(part 1 of 3)
# Autodesk Inventor assembly: ASSEMBLY_DUT_Ant_Rotator_REVC
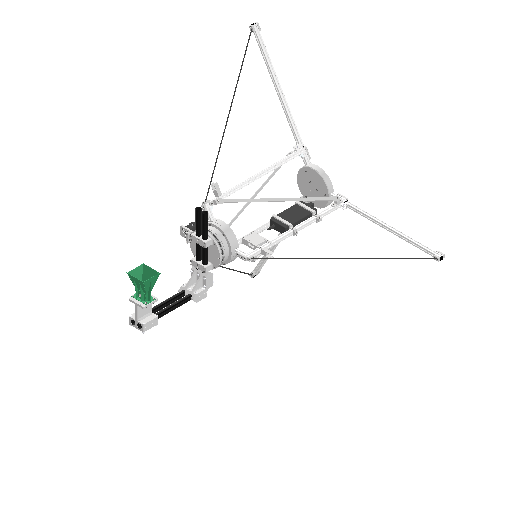
[picture p0: Inventor's stored thumbnail of the model, 512x512]
Saved by Autodesk Inventor 2027 (Build 310192060, 192F)
## iProperties
Created: 2026-01-06
Part Number: ASSEMBLY_DUT_Ant_Rotator_REVC
Document SubType Name: Assembly
Designer: User
Author: User
## Documents named in this file (74)
- C:\Users\lacze\OneDrive\_DRIVE_SYNCH_FILES\RF - Antenna Positioner\MCAD\1_V1\ASSEMBLY_DUT_ANT_ROTATOR_REVC\ASSEMBLY_DUT_Ant_Rotator_REVC.iam
- C:\Users\lacze\OneDrive\_DRIVE_SYNCH_FILES\RF - Antenna Positioner\MCAD\1_V1\__COTS_PARTS\COTS_CARBONCENTER_Fiberglass_Tube_27x24x383mm.ipt
- C:\Users\lacze\OneDrive\_DRIVE_SYNCH_FILES\RF - Antenna Positioner\MCAD\1_V1\__COTS_PARTS\COTS_GENERIC_6020_2RS_150x100x24mm_Ball_Bearing\COTS_GENERIC_6020_2RS_150x100x24mm_Ball_Bearing.ipt
- C:\Users\lacze\OneDrive\_DRIVE_SYNCH_FILES\RF - Antenna Positioner\MCAD\1_V1\ASSEMBLY_DUT_ANT_ROTATOR_REVA\3DP_PLA_A_Axis_Bearing_Base.ipt
- C:\Users\lacze\OneDrive\_DRIVE_SYNCH_FILES\RF - Antenna Positioner\MCAD\1_V1\ASSEMBLY_DUT_ANT_ROTATOR_REVA\3DP_PLA_A_Axis_Bearing_Base_Bearing_Locking_Ring.ipt
- C:\Users\lacze\OneDrive\_DRIVE_SYNCH_FILES\RF - Antenna Positioner\MCAD\1_V1\__CONTENT_CENTER_PARTS\en-US\ISO 7380-1\ISO 7380-1 - M4 x 40.ipt
- C:\Users\lacze\OneDrive\_DRIVE_SYNCH_FILES\RF - Antenna Positioner\MCAD\1_V1\__CONTENT_CENTER_PARTS\en-US\DIN 934\DIN 934 - M4 x 0,7.ipt
- C:\Users\lacze\OneDrive\_DRIVE_SYNCH_FILES\RF - Antenna Positioner\MCAD\1_V1\ASSEMBLY_DUT_ANT_ROTATOR_REVA\3DP_PLA_A_Axis_Rotating_Stage.ipt
- C:\Users\lacze\OneDrive\_DRIVE_SYNCH_FILES\RF - Antenna Positioner\MCAD\1_V1\ASSEMBLY_DUT_ANT_ROTATOR_REVA\3DP_PLA_A_Axis_Rotating_Stage_Mounting_Plate.ipt
- C:\Users\lacze\OneDrive\_DRIVE_SYNCH_FILES\RF - Antenna Positioner\MCAD\1_V1\__CONTENT_CENTER_PARTS\en-US\DIN 912\DIN 912 - M5 x 0,8 x 50 x 22.ipt
- C:\Users\lacze\OneDrive\_DRIVE_SYNCH_FILES\RF - Antenna Positioner\MCAD\1_V1\__CONTENT_CENTER_PARTS\en-US\DIN 934\DIN 934 - M5 x 0,8.ipt
- C:\Users\lacze\OneDrive\_DRIVE_SYNCH_FILES\RF - Antenna Positioner\MCAD\1_V1\__COTS_PARTS\COTS_GENERIC_HTD3M_24T_6mm_5mm_shaft_pulley.ipt
- C:\Users\lacze\OneDrive\_DRIVE_SYNCH_FILES\RF - Antenna Positioner\MCAD\1_V1\__COTS_PARTS\COTS_GENERIC_HTD3M_6mm_675mm_Closed_belt_A_Axis.ipt
- C:\Users\lacze\OneDrive\_DRIVE_SYNCH_FILES\RF - Antenna Positioner\MCAD\1_V1\ASSEMBLY_DUT_ANT_ROTATOR_REVA\ASSEMBLY_HTD3M_Idler_A_Axis.iam
- C:\Users\lacze\OneDrive\_DRIVE_SYNCH_FILES\RF - Antenna Positioner\MCAD\1_V1\__CONTENT_CENTER_PARTS\en-US\DIN 125-1  A\DIN 125 - A 3,2.ipt
- C:\Users\lacze\OneDrive\_DRIVE_SYNCH_FILES\RF - Antenna Positioner\MCAD\1_V1\__CONTENT_CENTER_PARTS\en-US\ISO 7380-1\ISO 7380-1 - M3 x 16.ipt
- C:\Users\lacze\OneDrive\_DRIVE_SYNCH_FILES\RF - Antenna Positioner\MCAD\1_V1\ASSEMBLY_DUT_ANT_ROTATOR_REVA\3DP_PLA_A_Axis_Rotating_Stage_Fiberglass_pipes_mount_plate.ipt
- C:\Users\lacze\OneDrive\_DRIVE_SYNCH_FILES\RF - Antenna Positioner\MCAD\1_V1\ASSEMBLY_DUT_ANT_ROTATOR_REVA\3DP_PLA_A_Axis_Rotating_Stage_Fiberglass_pipes_mount_clamp.ipt
- C:\Users\lacze\OneDrive\_DRIVE_SYNCH_FILES\RF - Antenna Positioner\MCAD\1_V1\__CONTENT_CENTER_PARTS\en-US\DIN 912\DIN 912 - M4 x 0,7 x 20 x 18,25.ipt
- C:\Users\lacze\OneDrive\_DRIVE_SYNCH_FILES\RF - Antenna Positioner\MCAD\1_V1\__COTS_PARTS\COTS_MKS_SERVO42D_40mm.ipt
- C:\Users\lacze\OneDrive\_DRIVE_SYNCH_FILES\RF - Antenna Positioner\MCAD\1_V1\ASSEMBLY_DUT_ANT_ROTATOR_REVA\3DP_PLA_Fiberglass_Pipe_Corner_Bracket.ipt
- C:\Users\lacze\OneDrive\_DRIVE_SYNCH_FILES\RF - Antenna Positioner\MCAD\1_V1\ASSEMBLY_DUT_ANT_ROTATOR_REVA\3DP_PLA_Fiberglass_Pipe_Corner_Bracket_Clamp.ipt
- C:\Users\lacze\OneDrive\_DRIVE_SYNCH_FILES\RF - Antenna Positioner\MCAD\1_V1\__COTS_PARTS\COTS_DREMEC_8G206M6X50_M6x50_Nylon_Screw.ipt
- COTS_DREMEC_8G206M6X50_M6x50_Nylon_Screw.ipt
- C:\Users\lacze\OneDrive\_DRIVE_SYNCH_FILES\RF - Antenna Positioner\MCAD\1_V1\__COTS_PARTS\COTS_BOSSARD_1400444_M6_Nylon_Nut.ipt
- C:\Users\lacze\OneDrive\_DRIVE_SYNCH_FILES\RF - Antenna Positioner\MCAD\1_V1\__CONTENT_CENTER_PARTS\en-US\DIN 912\DIN 912 - M4 x 0,7 x 35 x 20.ipt
- C:\Users\lacze\OneDrive\_DRIVE_SYNCH_FILES\RF - Antenna Positioner\MCAD\1_V1\__COTS_PARTS\COTS_BYTECHLAB_COAXIAL_FEED_HORN\COTS_BYTECHLAB_Coaxial_Feed_Horn.iam
- C:\Users\lacze\OneDrive\_DRIVE_SYNCH_FILES\RF - Antenna Positioner\MCAD\1_V1\ASSEMBLY_DUT_ANT_ROTATOR_REVA\3DP_PLA_Antenna_Boom_Fiberglass_Pipe_Clamp.ipt
- C:\Users\lacze\OneDrive\_DRIVE_SYNCH_FILES\RF - Antenna Positioner\MCAD\1_V1\__COTS_PARTS\COTS_Profihot_HC-2-22x16_Zip_Tie_Anchor.ipt
- C:\Users\lacze\OneDrive\_DRIVE_SYNCH_FILES\RF - Antenna Positioner\MCAD\1_V1\__COTS_PARTS\COTS_BOSSARD_1386883_M4_Threaded_Insert\COTS_BOSSARD_1386883_M4_Threaded_Insert.ipt
- C:\Users\lacze\OneDrive\_DRIVE_SYNCH_FILES\RF - Antenna Positioner\MCAD\1_V1\__CONTENT_CENTER_PARTS\en-US\DIN 125-1  A\DIN 125 - A 4,3.ipt
- C:\Users\lacze\OneDrive\_DRIVE_SYNCH_FILES\RF - Antenna Positioner\MCAD\1_V1\__CONTENT_CENTER_PARTS\en-US\ISO 7380-1\ISO 7380-1 - M4 x 8.ipt
- C:\Users\lacze\OneDrive\_DRIVE_SYNCH_FILES\RF - Antenna Positioner\MCAD\1_V1\ASSEMBLY_DUT_ANT_ROTATOR_REVA\3DP_PLA_A_Axis_Idler_Stiffening_Bracket.ipt
- C:\Users\lacze\OneDrive\_DRIVE_SYNCH_FILES\RF - Antenna Positioner\MCAD\1_V1\ASSEMBLY_DUT_ANT_ROTATOR_REVB\3DP_PLA_A_Axis_Bearing_Base_Stand_Mount_REVB.ipt
- C:\Users\lacze\OneDrive\_DRIVE_SYNCH_FILES\RF - Antenna Positioner\MCAD\1_V1\__COTS_PARTS\COTS_Fleximo_FB12020_20x20_Alu_Profile_150mm.ipt
- C:\Users\lacze\OneDrive\_DRIVE_SYNCH_FILES\RF - Antenna Positioner\MCAD\1_V1\__COTS_PARTS\COTS_Fleximo_FB12020_20x20_Alu_Profile_600mm.ipt
- C:\Users\lacze\OneDrive\_DRIVE_SYNCH_FILES\RF - Antenna Positioner\MCAD\1_V1\__COTS_PARTS\COTS_Fleximo_FB1K2020_Angle\COTS_Fleximo_FB1K2020_Angle.ipt
- C:\Users\lacze\OneDrive\_DRIVE_SYNCH_FILES\RF - Antenna Positioner\MCAD\1_V1\__COTS_PARTS\COTS_Fleximo_FB1ZP20C_20x20_End_Cap\COTS_Fleximo_FB1ZP20C_20x20_End_Cap.ipt
- C:\Users\lacze\OneDrive\_DRIVE_SYNCH_FILES\RF - Antenna Positioner\MCAD\1_V1\__COTS_PARTS\COTS_Fleximo_FB12020_20x20_Alu_Profile_575mm.ipt
- C:\Users\lacze\OneDrive\_DRIVE_SYNCH_FILES\RF - Antenna Positioner\MCAD\1_V1\__COTS_PARTS\COTS_Fleximo_FBP2020_20x20_Hinge\COTS_Fleximo_FBP2020_20x20_Hinge.ipt
- C:\Users\lacze\OneDrive\_DRIVE_SYNCH_FILES\RF - Antenna Positioner\MCAD\1_V1\__COTS_PARTS\COTS_GENERIC_5mm_Carbon_Rod.ipt
- C:\Users\lacze\OneDrive\_DRIVE_SYNCH_FILES\RF - Antenna Positioner\MCAD\1_V1\__COTS_PARTS\COTS_Fleximo_FB1NM3_M3_Nut_20x20\COTS_Fleximo_FB1NM3_M3_Nut_20x20.ipt
- C:\Users\lacze\OneDrive\_DRIVE_SYNCH_FILES\RF - Antenna Positioner\MCAD\1_V1\__CONTENT_CENTER_PARTS\en-US\ISO 7380-1\ISO 7380-1 - M3 x 12.ipt
- C:\Users\lacze\OneDrive\_DRIVE_SYNCH_FILES\RF - Antenna Positioner\MCAD\1_V1\__CONTENT_CENTER_PARTS\en-US\DIN 125-1  A\DIN 125 - A 5,3.ipt
- C:\Users\lacze\OneDrive\_DRIVE_SYNCH_FILES\RF - Antenna Positioner\MCAD\1_V1\__CONTENT_CENTER_PARTS\en-US\DIN 912\DIN 912 - M5 x 0,8 x 30 x 22.ipt
- C:\Users\lacze\OneDrive\_DRIVE_SYNCH_FILES\RF - Antenna Positioner\MCAD\1_V1\ASSEMBLY_DUT_ANT_ROTATOR_REVB\3DP_PLA_A_Axis_Bearing_Base_Stand_Mount_Bottom_REVB.ipt
- C:\Users\lacze\OneDrive\_DRIVE_SYNCH_FILES\RF - Antenna Positioner\MCAD\1_V1\__COTS_PARTS\COTS_Fleximo_FB1NM4_M4_Nut_20x20\COTS_Fleximo_FB1NM4_M4_Nut_20x20.ipt
- C:\Users\lacze\OneDrive\_DRIVE_SYNCH_FILES\RF - Antenna Positioner\MCAD\1_V1\__CONTENT_CENTER_PARTS\en-US\DIN 912\DIN 912 - M4 x 0,7 x 10 x 8,25.ipt
- C:\Users\lacze\OneDrive\_DRIVE_SYNCH_FILES\RF - Antenna Positioner\MCAD\1_V1\__CONTENT_CENTER_PARTS\en-US\DIN 912\DIN 912 - M4 x 0,7 x 16 x 14,25.ipt
- C:\Users\lacze\OneDrive\_DRIVE_SYNCH_FILES\RF - Antenna Positioner\MCAD\1_V1\ASSEMBLY_DUT_ANT_ROTATOR_REVB\3DP_PLA_A_Axis_Bearing_Base_Stand_Bottom_Plate_REVB.ipt
- C:\Users\lacze\OneDrive\_DRIVE_SYNCH_FILES\RF - Antenna Positioner\MCAD\1_V1\ASSEMBLY_DUT_ANT_ROTATOR_REVB\3DP_PLA_Foldable_Leg_Brace_Mount_REVB.ipt
- C:\Users\lacze\OneDrive\_DRIVE_SYNCH_FILES\RF - Antenna Positioner\MCAD\1_V1\ASSEMBLY_DUT_ANT_ROTATOR_REVB\3DP_PLA_A_Axis_Stepper_Mount_REVB.ipt
- C:\Users\lacze\OneDrive\_DRIVE_SYNCH_FILES\RF - Antenna Positioner\MCAD\1_V1\__COTS_PARTS\COTS_GENERIC_24V_Power_Brick.ipt
- C:\Users\lacze\OneDrive\_DRIVE_SYNCH_FILES\RF - Antenna Positioner\MCAD\1_V1\ASSEMBLY_DUT_ANT_ROTATOR_REVB\3DP_PLA_Power_Brick_Mounting_Clamp_REVB.ipt
- C:\Users\lacze\OneDrive\_DRIVE_SYNCH_FILES\RF - Antenna Positioner\MCAD\1_V1\ASSEMBLY_DUT_ANT_ROTATOR_REVB\3DP_PLA_Alu_Frame_Brace_REVB.ipt
- C:\Users\lacze\OneDrive\_DRIVE_SYNCH_FILES\RF - Antenna Positioner\MCAD\1_V1\ASSEMBLY_DUT_ANT_ROTATOR_REVB\LC_3mm_ALU_Alu_Frame_Brace_REVB.ipt
- C:\Users\lacze\OneDrive\_DRIVE_SYNCH_FILES\RF - Antenna Positioner\MCAD\1_V1\__CONTENT_CENTER_PARTS\en-US\DIN 912\DIN 912 - M4 x 0,7 x 25 x 23,25.ipt
- C:\Users\lacze\OneDrive\_DRIVE_SYNCH_FILES\RF - Antenna Positioner\MCAD\1_V1\ASSEMBLY_DUT_ANT_ROTATOR_REVB\3DP_PLA_Folded_Leg_Holder_REVB.ipt
- C:\Users\lacze\OneDrive\_DRIVE_SYNCH_FILES\RF - Antenna Positioner\MCAD\1_V1\ASSEMBLY_DUT_ANT_ROTATOR_REVB\3DP_PLA_Carbon_Rod_Holder_Top_REVB.ipt
- C:\Users\lacze\OneDrive\_DRIVE_SYNCH_FILES\RF - Antenna Positioner\MCAD\1_V1\ASSEMBLY_DUT_ANT_ROTATOR_REVB\3DP_PLA_Carbon_Rod_Holder_Bottom_REVB.ipt
- C:\Users\lacze\OneDrive\_DRIVE_SYNCH_FILES\RF - Antenna Positioner\MCAD\1_V1\ASSEMBLY_DUT_ANT_ROTATOR_REVB\3DP_PLA_Frame_Stiffener_and_Leg_REVB.ipt
- C:\Users\lacze\OneDrive\_DRIVE_SYNCH_FILES\RF - Antenna Positioner\MCAD\1_V1\__CONTENT_CENTER_PARTS\en-US\ISO 7380-1\ISO 7380-1 - M6 x 16.ipt
- C:\Users\lacze\OneDrive\_DRIVE_SYNCH_FILES\RF - Antenna Positioner\MCAD\1_V1\__CONTENT_CENTER_PARTS\en-US\ISO 7380-1\ISO 7380-1 - M5 x 8.ipt
- C:\Users\lacze\OneDrive\_DRIVE_SYNCH_FILES\RF - Antenna Positioner\MCAD\1_V1\ASSEMBLY_DUT_ANT_ROTATOR_REVB\3DP_PLA_Frame_Leg_Leg_REVB.ipt
- C:\Users\lacze\OneDrive\_DRIVE_SYNCH_FILES\RF - Antenna Positioner\MCAD\1_V1\ASSEMBLY_DUT_ANT_ROTATOR_REVB\3DP_PLA_Electronics_Box_Bottom_REVB.ipt
- C:\Users\lacze\OneDrive\_DRIVE_SYNCH_FILES\RF - Antenna Positioner\MCAD\1_V1\__KICAD_PCB_PARTS\1_SERVO_CONN_PCB\ASSEMBLY_PCB_SERVO_CONN.iam
- C:\Users\lacze\OneDrive\_DRIVE_SYNCH_FILES\RF - Antenna Positioner\MCAD\1_V1\__COTS_PARTS\COTS_MKS_Canable_2_0.ipt
- C:\Users\lacze\OneDrive\_DRIVE_SYNCH_FILES\RF - Antenna Positioner\MCAD\1_V1\ASSEMBLY_DUT_ANT_ROTATOR_REVB\3DP_PLA_Electronics_Box_Top_REVB.ipt
- C:\Users\lacze\OneDrive\_DRIVE_SYNCH_FILES\RF - Antenna Positioner\MCAD\1_V1\__CONTENT_CENTER_PARTS\en-US\ISO 7380-1\ISO 7380-1 - M3 x 6.ipt
- C:\Users\lacze\OneDrive\_DRIVE_SYNCH_FILES\RF - Antenna Positioner\MCAD\1_V1\__CONTENT_CENTER_PARTS\en-US\DIN 912\DIN 912 - M2 x 0,4 x 6 x 5.ipt
- C:\Users\lacze\OneDrive\_DRIVE_SYNCH_FILES\RF - Antenna Positioner\MCAD\1_V1\__CONTENT_CENTER_PARTS\en-US\DIN 912\DIN 912 - M3 x 0,5 x 30 x 18.ipt
- C:\Users\lacze\OneDrive\_DRIVE_SYNCH_FILES\RF - Antenna Positioner\MCAD\1_V1\__CONTENT_CENTER_PARTS\en-US\DIN 934\DIN 934 - M3 x 0,5.ipt
- C:\Users\lacze\OneDrive\_DRIVE_SYNCH_FILES\RF - Antenna Positioner\MCAD\1_V1\__CONTENT_CENTER_PARTS\en-US\DIN 912\DIN 912 - M3 x 0,5 x 8 x 6,75.ipt
- C:\Users\lacze\OneDrive\_DRIVE_SYNCH_FILES\RF - Antenna Positioner\MCAD\1_V1\ASSEMBLY_DUT_ANT_ROTATOR_REVC\3DP_PLA_Antenna_Boom_Coax_Feed_Horn_REVC.ipt
## Components (435 placed, 72 different names)
1. COTS_GENERIC_6020_2RS_150x100x24mm_Ball_Bearing:1 — Mate:3, Mate:4, Mate:40, Mate:41, Mate:42, Mate:43
2. 3DP_PLA_A_Axis_Bearing_Base:1 — Mate:1, Mate:2, Mate:3, Mate:4, Mate:5, Mate:6, Mate:7, Mate:25, Mate:27, Mate:29, Mate:31, Mate:33, Mate:35, Mate:37, Mate:39, Angle:1, Angle:2, Angle:3, Angle:4, Angle:5, Angle:6, Angle:7, Angle:8, Angle:17, Mate:80, Mate:81, Mate:82, Mate:90, Mate:92, Mate:94, Angle:18, Angle:19, Angle:20, Mate:576, Angle:64, Mate:577, Flush:24, Mate:625, Mate:627, Mate:781, Mate:782, Mate:783, Mate:784, Mate:785, Mate:786, Mate:787, Mate:788, Mate:789, Mate:790, Mate:791, Mate:792, Mate:793, Mate:794, Mate:796, Mate:798, Mate:800, Mate:802, Mate:804
3. 3DP_PLA_A_Axis_Bearing_Base_Bearing_Locking_Ring:1 — Mate:5, Mate:6, Mate:7, Mate:8, Mate:9, Mate:10, Mate:11, Mate:12, Mate:13, Mate:14, Mate:15, Mate:16, Mate:17, Mate:18, Mate:19, Mate:20, Mate:21, Mate:22, Mate:23, Mate:24, Mate:26, Mate:28, Mate:30, Mate:32, Mate:34, Mate:36, Mate:38
4. COTS_MKS_SERVO42D_40mm:1 — Mate:77, Mate:107, Mate:108, Mate:109, Mate:110, Mate:112, Mate:114, Mate:116
5. 3DP_PLA_A_Axis_Rotating_Stage:1 — Mate:40, Mate:41, Mate:44, Mate:45, Mate:46, Mate:47, Mate:48, Mate:49, Mate:50, Mate:51, Mate:52, Mate:53, Mate:54, Mate:55, Mate:56, Mate:57, Mate:58, Mate:59, Mate:60, Mate:61, Mate:63, Mate:65, Mate:67, Mate:69, Mate:71, Mate:73, Mate:75, Mate:78, Mate:79, Mate:121, Mate:122, Mate:123, Mate:194, Mate:196, Mate:198, Mate:200, Mate:202, Mate:204, Mate:206, Mate:208, Angle:33, Angle:34, Angle:35, Angle:36, Angle:37, Angle:38, Angle:39, Angle:40
6. 3DP_PLA_A_Axis_Rotating_Stage_Mounting_Plate:1 — Mate:42, Mate:43, Mate:44, Mate:62, Mate:64, Mate:66, Mate:68, Mate:70, Mate:72, Mate:74, Mate:76, Angle:9, Angle:10, Angle:11, Angle:12, Angle:13, Angle:14, Angle:15, Angle:16
7. COTS_GENERIC_HTD3M_24T_6mm_5mm_shaft_pulley:1 — Mate:77, Mate:118, Mate:119
8. COTS_GENERIC_HTD3M_6mm_675mm_Closed_belt_A_Axis:1 — Mate:78, Mate:79, Mate:118, Mate:119
9. 3DP_PLA_A_Axis_Stepper_Mount_REVB:1 — Mate:80, Mate:81, Mate:82, Mate:83, Mate:84, Mate:85, Mate:86, Mate:87, Mate:88, Mate:89, Mate:91, Mate:93, Mate:95, Mate:96, Mate:97, Mate:98, Mate:107, Mate:108, Mate:109, Mate:111, Mate:113, Mate:115, Mate:117, Mate:600, Mate:602
10. ASSEMBLY_HTD3M_Idler_A_Axis:1 [sub-assembly] — Mate:96, Mate:98, Mate:594
11. ASSEMBLY_HTD3M_Idler_A_Axis:2 [sub-assembly] — Mate:95, Mate:97, Mate:592, Mate:593
12. 3DP_PLA_A_Axis_Rotating_Stage_Fiberglass_pipes_mount_plate:1 — Mate:121, Mate:122, Mate:123, Mate:127, Mate:128, Flush:3, Flush:4, Flush:5, Flush:6, Mate:154, Mate:156, Mate:158, Mate:160, Mate:162, Mate:164, Mate:166, Mate:168, Mate:170, Mate:172, Mate:174, Mate:176, Angle:21, Angle:22, Angle:23, Angle:24, Angle:25, Angle:26, Angle:27, Angle:28, Angle:29, Angle:30, Angle:31, Angle:32, Mate:177, Mate:178, Mate:179, Mate:180, Mate:181, Mate:182, Mate:183, Mate:184, Mate:185, Mate:186, Mate:187, Mate:188, Mate:189, Mate:190, Mate:191, Mate:192, Mate:193, Mate:195, Mate:197, Mate:199, Mate:201, Mate:203, Mate:205, Mate:207, Angle:41, Mate:958, Mate:959
13. 3DP_PLA_A_Axis_Rotating_Stage_Fiberglass_pipes_mount_clamp:1 — Mate:128, Flush:5, Flush:6, Mate:141, Mate:143, Mate:145, Mate:147, Mate:149, Mate:151, Mate:165, Mate:167, Mate:169, Mate:171, Mate:173, Mate:175, Mate:960
14. 3DP_PLA_A_Axis_Rotating_Stage_Fiberglass_pipes_mount_clamp:2 — Mate:127, Flush:3, Flush:4, Mate:129, Mate:130, Mate:131, Mate:132, Mate:133, Mate:134, Mate:135, Mate:136, Mate:137, Mate:138, Mate:139, Mate:140, Mate:142, Mate:144, Mate:146, Mate:148, Mate:150, Mate:152, Mate:153, Mate:155, Mate:157, Mate:159, Mate:161, Mate:163
15. COTS_CARBONCENTER_Fiberglass_Tube_27x24x383mm:5 — Mate:251, Mate:254, Flush:11, Mate:958
16. COTS_CARBONCENTER_Fiberglass_Tube_27x24x383mm:6 — Mate:250, Mate:255, Flush:12, Mate:959
17. COTS_CARBONCENTER_Fiberglass_Tube_27x24x383mm:7 — Mate:253, Mate:256, Flush:13, Mate:501, Mate:503
18. COTS_CARBONCENTER_Fiberglass_Tube_27x24x383mm:8 — Mate:252, Mate:257, Flush:14, Mate:500, Flush:22, Mate:502
19. 3DP_PLA_Fiberglass_Pipe_Corner_Bracket:2 — Mate:250, Mate:251, Mate:252, Mate:253, Flush:9, Flush:10, Mate:306, Mate:307, Mate:308, Mate:309, Mate:310, Mate:311, Mate:312, Mate:313, Mate:314, Mate:315, Mate:316, Mate:317, Mate:960
20. 3DP_PLA_Fiberglass_Pipe_Corner_Bracket_Clamp:2 — Mate:254, Mate:255, Flush:10, Flush:11, Flush:12, Mate:282, Mate:283, Mate:284, Mate:285, Mate:286, Mate:287, Mate:300, Mate:301, Mate:302, Mate:303, Mate:304, Mate:305
21. 3DP_PLA_Fiberglass_Pipe_Corner_Bracket_Clamp:3 — Mate:256, Mate:257, Flush:9, Flush:13, Flush:14, Mate:288, Mate:289, Mate:290, Mate:291, Mate:292, Mate:293, Mate:294, Mate:295, Mate:296, Mate:297, Mate:298, Mate:299
22. COTS_BYTECHLAB_Coaxial_Feed_Horn:1 [sub-assembly] — Mate:520, Mate:961, Mate:962
23. 3DP_PLA_Antenna_Boom_Coax_Feed_Horn_REVC:1 — Mate:500, Mate:501, Flush:22, Flush:23, Mate:504, Mate:505, Mate:506, Mate:507, Mate:508, Mate:509, Mate:510, Mate:511, Mate:520, Mate:961, Mate:962
24. 3DP_PLA_Antenna_Boom_Fiberglass_Pipe_Clamp:1 — Mate:502, Mate:503, Flush:23, Mate:512, Mate:513, Mate:514, Mate:515
25. COTS_Profihot_HC-2-22x16_Zip_Tie_Anchor:1 — Mate:576, Angle:64, Mate:578, Mate:579, Mate:580
26. 3DP_PLA_A_Axis_Idler_Stiffening_Bracket:1 — Mate:592, Mate:593, Mate:594, Mate:595, Mate:596, Mate:597, Mate:598, Mate:599, Mate:601
27. 3DP_PLA_A_Axis_Bearing_Base_Stand_Mount_REVB:1 — Mate:625, Mate:627, Mate:629, Mate:630, Mate:690, Mate:751, Mate:753, Mate:755, Mate:757, Mate:759, Mate:761, Mate:763, Mate:765, Mate:767, Mate:781, Mate:795, Mate:797, Mate:799, Mate:801, Mate:803, Mate:805
28. 3DP_PLA_A_Axis_Bearing_Base_Stand_Mount_Bottom_REVB:1 — Mate:691, Mate:730, Mate:731, Mate:732, Mate:733, Mate:734, Mate:735, Mate:736, Mate:737, Mate:738, Mate:739, Mate:740, Mate:741, Mate:742, Mate:743, Mate:744, Mate:745, Mate:746, Mate:747, Mate:748, Mate:749, Mate:750, Mate:752, Mate:754, Mate:756, Mate:758, Mate:760, Mate:762, Mate:764, Mate:766, Mate:768, Mate:769
29. 3DP_PLA_A_Axis_Bearing_Base_Stand_Bottom_Plate_REVB:1 — Mate:770, Mate:771, Mate:772, Mate:775, Mate:776, Mate:777, Mate:778, Mate:779, Mate:780
30. COTS_GENERIC_24V_Power_Brick:1 — Mate:827, Mate:828, Flush:45
31. 3DP_PLA_Power_Brick_Mounting_Clamp_REVB:1 — Mate:818, Flush:44, Mate:826, Mate:828, Mate:829, Flush:45, Mate:831, Mate:832, Mate:834, Mate:836, Mate:837, Mate:838, Mate:839, Mate:845, Mate:847, Mate:848, Mate:850
32. 3DP_PLA_Power_Brick_Mounting_Clamp_REVB:2 — Mate:819, Mate:825, Flush:43, Mate:829, Mate:830, Mate:833, Mate:835, Mate:841, Mate:843, Mate:849
33. 3DP_PLA_Power_Brick_Mounting_Clamp_REVB:3 — Mate:820, Mate:824, Flush:43, Mate:853
34. 3DP_PLA_Power_Brick_Mounting_Clamp_REVB:4 — Mate:821, Mate:822, Flush:44, Mate:827, Mate:840, Mate:842, Mate:844, Mate:846, Mate:851, Mate:852, Mate:854
35. 3DP_PLA_Carbon_Rod_Holder_Bottom_REVB:1 — Mate:880, Flush:50, Flush:51, Mate:886, Mate:888
36. 3DP_PLA_Carbon_Rod_Holder_Top_REVB:1 — Mate:881, Flush:52, Flush:53, Mate:882, Mate:883, Mate:884, Mate:885, Mate:887, Mate:889
37. 3DP_PLA_Electronics_Box_Bottom_REVB:1 — Mate:909, Mate:910, Mate:911, Mate:912, Mate:913, Mate:914, Mate:915, Mate:916, Flush:60, Mate:917, Flush:61, Flush:62, Mate:934, Mate:935, Mate:936, Mate:937, Mate:938, Mate:939, Mate:940, Mate:941, Mate:942, Mate:944, Mate:946, Mate:948, Mate:954, Mate:955, Mate:956, Mate:957
38. ASSEMBLY_PCB_SERVO_CONN:1 [sub-assembly] — Mate:909, Mate:910, Mate:911, Mate:918, Mate:919, Mate:920, Mate:921, Mate:922, Mate:923, Mate:924, Mate:925
39. COTS_MKS_Canable_2_0:1 — Mate:912, Mate:913, Mate:914, Mate:926, Mate:927, Mate:928, Mate:929, Mate:930, Mate:931, Mate:932, Mate:933
40. 3DP_PLA_Electronics_Box_Top_REVB:1 — Mate:917, Flush:61, Flush:62, Mate:943, Mate:945, Mate:947, Mate:949, Mate:950, Mate:951, Mate:952, Mate:953
41. DIN 912 - replaced by DIN EN ISO 4762 M3 x 8:4 — Mate:956, Mate:957
42. DIN 912 - replaced by DIN EN ISO 4762 M3 x 8:3 — Mate:954, Mate:955
43. DIN 912 - replaced by DIN EN ISO 4762 M3 x 8:2 — Mate:952, Mate:953
44. DIN 912 - replaced by DIN EN ISO 4762 M3 x 8:1 — Mate:950, Mate:951
45. DIN 934 - replaced by DIN EN 24032/28673/28674 M3:4 — Mate:948, Mate:949
46. DIN 934 - replaced by DIN EN 24032/28673/28674 M3:3 — Mate:946, Mate:947
47. DIN 934 - replaced by DIN EN 24032/28673/28674 M3:2 — Mate:944, Mate:945
48. DIN 912 - replaced by DIN EN ISO 4762 M3 x 30:4 — Mate:940, Mate:941
49. DIN 912 - replaced by DIN EN ISO 4762 M3 x 30:3 — Mate:938, Mate:939
50. DIN 912 - replaced by DIN EN ISO 4762 M3 x 30:2 — Mate:936, Mate:937
51. DIN 934 - replaced by DIN EN 24032/28673/28674 M3:1 — Mate:942, Mate:943
52. DIN 912 - replaced by DIN EN ISO 4762 M3 x 30:1 — Mate:934, Mate:935
53. DIN 912 - replaced by DIN EN ISO 4762 M2 x 6:4 — Mate:932, Mate:933
54. DIN 912 - replaced by DIN EN ISO 4762 M2 x 6:3 — Mate:930, Mate:931
55. DIN 912 - replaced by DIN EN ISO 4762 M2 x 6:2 — Mate:928, Mate:929
56. DIN 912 - replaced by DIN EN ISO 4762 M2 x 6:1 — Mate:926, Mate:927
57. ISO 7380-1 M3 x 6:4 — Mate:924, Mate:925
58. ISO 7380-1 M3 x 6:3 — Mate:922, Mate:923
59. ISO 7380-1 M3 x 6:2 — Mate:920, Mate:921
60. ISO 7380-1 M3 x 6:1 — Mate:918, Mate:919
61. DIN 912 - replaced by DIN EN ISO 4762 M4 x 10:23 — Insert:53
62. DIN 912 - replaced by DIN EN ISO 4762 M4 x 10:22 — Insert:52
63. DIN 912 - replaced by DIN EN ISO 4762 M4 x 10:21 — Insert:51
64. DIN 125-1 A A 4,3:42 — Mate:888, Mate:889, Insert:53
65. DIN 125-1 A A 4,3:41 — Mate:886, Mate:887, Insert:52
66. DIN 125-1 A A 4,3:40 — Mate:884, Mate:885, Insert:51
67. DIN 912 - replaced by DIN EN ISO 4762 M4 x 10:20 — Insert:50
68. DIN 125-1 A A 4,3:39 — Mate:882, Mate:883, Insert:50
69. DIN 912 - replaced by DIN EN ISO 4762 M4 x 10:7 — Mate:853, Mate:854
70. DIN 912 - replaced by DIN EN ISO 4762 M4 x 10:6 — Mate:851, Mate:852
71. DIN 912 - replaced by DIN EN ISO 4762 M4 x 10:5 — Mate:849, Mate:850
72. DIN 912 - replaced by DIN EN ISO 4762 M4 x 10:4 — Mate:847, Mate:848
73. DIN 934 - replaced by DIN EN 24032/28673/28674 M4:32 — Insert:43
74. DIN 934 - replaced by DIN EN 24032/28673/28674 M4:31 — Insert:42
75. DIN 934 - replaced by DIN EN 24032/28673/28674 M4:30 — Insert:41
76. DIN 125-1 A A 4,3:20 — Mate:845, Mate:846, Insert:43
77. DIN 125-1 A A 4,3:19 — Mate:843, Mate:844, Insert:42
78. DIN 125-1 A A 4,3:18 — Mate:841, Mate:842, Insert:41
79. DIN 912 - replaced by DIN EN ISO 4762 M4 x 20:12 — Insert:39
80. DIN 912 - replaced by DIN EN ISO 4762 M4 x 20:11 — Insert:38
81. DIN 912 - replaced by DIN EN ISO 4762 M4 x 20:10 — Insert:37
82. DIN 125-1 A A 4,3:17 — Mate:837, Mate:838, Insert:39
83. DIN 125-1 A A 4,3:16 — Mate:835, Mate:836, Insert:38
84. DIN 125-1 A A 4,3:15 — Mate:833, Mate:834, Insert:37
85. DIN 934 - replaced by DIN EN 24032/28673/28674 M4:29 — Insert:40
86. DIN 125-1 A A 4,3:14 — Mate:839, Mate:840, Insert:40
87. DIN 912 - replaced by DIN EN ISO 4762 M4 x 20:9 — Insert:36
88. DIN 125-1 A A 4,3:13 — Mate:831, Mate:832, Insert:36
89. DIN 934 - replaced by DIN EN 24032/28673/28674 M5:35 — Mate:766, Mate:767
90. DIN 934 - replaced by DIN EN 24032/28673/28674 M5:34 — Mate:764, Mate:765
91. DIN 934 - replaced by DIN EN 24032/28673/28674 M5:33 — Mate:762, Mate:763
92. DIN 934 - replaced by DIN EN 24032/28673/28674 M5:32 — Mate:760, Mate:761
93. DIN 934 - replaced by DIN EN 24032/28673/28674 M5:31 — Mate:758, Mate:759
94. DIN 934 - replaced by DIN EN 24032/28673/28674 M5:30 — Mate:756, Mate:757
95. DIN 934 - replaced by DIN EN 24032/28673/28674 M5:29 — Mate:754, Mate:755
96. DIN 934 - replaced by DIN EN 24032/28673/28674 M5:28 — Mate:752, Mate:753
97. DIN 912 - replaced by DIN EN ISO 4762 M5 x 30:15 — Insert:26
98. DIN 912 - replaced by DIN EN ISO 4762 M5 x 30:14 — Insert:25
99. DIN 912 - replaced by DIN EN ISO 4762 M5 x 30:13 — Insert:24
100. DIN 912 - replaced by DIN EN ISO 4762 M5 x 30:12 — Insert:23
101. DIN 912 - replaced by DIN EN ISO 4762 M5 x 30:11 — Insert:22
102. DIN 912 - replaced by DIN EN ISO 4762 M5 x 30:10 — Insert:21
103. DIN 912 - replaced by DIN EN ISO 4762 M5 x 30:9 — Insert:20
104. DIN 912 - replaced by DIN EN ISO 4762 M5 x 30:8 — Insert:19
105. DIN 125-1 A A 5,3:15 — Mate:748, Mate:749, Insert:26
106. DIN 125-1 A A 5,3:14 — Mate:746, Mate:747, Insert:25
107. DIN 125-1 A A 5,3:13 — Mate:744, Mate:745, Insert:24
108. DIN 125-1 A A 5,3:12 — Mate:742, Mate:743, Insert:23
109. DIN 125-1 A A 5,3:11 — Mate:740, Mate:741, Insert:22
110. DIN 125-1 A A 5,3:10 — Mate:738, Mate:739, Insert:21
111. DIN 125-1 A A 5,3:9 — Mate:736, Mate:737, Insert:20
112. DIN 125-1 A A 5,3:8 — Mate:734, Mate:735, Insert:19
113. DIN 934 - replaced by DIN EN 24032/28673/28674 M5:27 — Mate:750, Mate:751
114. DIN 912 - replaced by DIN EN ISO 4762 M5 x 30:7 — Insert:18
115. DIN 125-1 A A 5,3:7 — Mate:732, Mate:733, Insert:18
116. DIN 934 - replaced by DIN EN 24032/28673/28674 M5:41 — Mate:804, Mate:805
117. DIN 934 - replaced by DIN EN 24032/28673/28674 M5:40 — Mate:802, Mate:803
118. DIN 934 - replaced by DIN EN 24032/28673/28674 M5:39 — Mate:800, Mate:801
119. DIN 934 - replaced by DIN EN 24032/28673/28674 M5:38 — Mate:798, Mate:799
120. DIN 934 - replaced by DIN EN 24032/28673/28674 M5:37 — Mate:796, Mate:797
121. DIN 912 - replaced by DIN EN ISO 4762 M5 x 30:21 — Insert:35
122. DIN 912 - replaced by DIN EN ISO 4762 M5 x 30:20 — Insert:34
123. DIN 912 - replaced by DIN EN ISO 4762 M5 x 30:19 — Insert:33
124. DIN 912 - replaced by DIN EN ISO 4762 M5 x 30:18 — Insert:32
125. DIN 912 - replaced by DIN EN ISO 4762 M5 x 30:17 — Insert:31
126. DIN 125-1 A A 5,3:21 — Mate:792, Mate:793, Insert:35
127. DIN 125-1 A A 5,3:20 — Mate:790, Mate:791, Insert:34
128. DIN 125-1 A A 5,3:19 — Mate:788, Mate:789, Insert:33
129. DIN 125-1 A A 5,3:18 — Mate:786, Mate:787, Insert:32
130. DIN 125-1 A A 5,3:17 — Mate:784, Mate:785, Insert:31
131. DIN 934 - replaced by DIN EN 24032/28673/28674 M5:36 — Mate:794, Mate:795
132. DIN 912 - replaced by DIN EN ISO 4762 M5 x 30:16 — Insert:30
133. DIN 125-1 A A 5,3:16 — Mate:782, Mate:783, Insert:30
134. DIN 912 - replaced by DIN EN ISO 4762 M4 x 35:3 — Mate:595, Mate:596
135. DIN 934 - replaced by DIN EN 24032/28673/28674 M4:25 — Mate:599, Mate:600
136. DIN 912 - replaced by DIN EN ISO 4762 M4 x 35:4 — Mate:597, Mate:598
137. DIN 934 - replaced by DIN EN 24032/28673/28674 M4:26 — Mate:601, Mate:602
138. COTS_BOSSARD_1386883_M4_Threaded_Insert:1 — Mate:577, Flush:24, Mate:578
139. DIN 125-1 A A 4,3:1 — Mate:579, Mate:580, Insert:9
140. ISO 7380-1 M4 x 8:1 — Insert:9
141. COTS_BOSSARD_1400444_M6_Nylon_Nut:66 — Mate:513, Mate:517
142. COTS_BOSSARD_1400444_M6_Nylon_Nut:65 — Mate:514, Mate:519
143. COTS_BOSSARD_1400444_M6_Nylon_Nut:64 — Mate:515, Mate:516
144. COTS_BOSSARD_1400444_M6_Nylon_Nut:63 — Mate:512, Mate:518
145. COTS_DREMEC_8G206M6X50_M6x50_Nylon_Screw:66 — Mate:507, Mate:508, Mate:516
146. COTS_DREMEC_8G206M6X50_M6x50_Nylon_Screw:65 — Mate:506, Mate:511, Mate:519
147. COTS_DREMEC_8G206M6X50_M6x50_Nylon_Screw:64 — Mate:505, Mate:509, Mate:517
148. COTS_DREMEC_8G206M6X50_M6x50_Nylon_Screw:63 — Mate:504, Mate:510, Mate:518
149. COTS_BOSSARD_1400444_M6_Nylon_Nut:24 — Mate:317, Mate:328
150. COTS_BOSSARD_1400444_M6_Nylon_Nut:23 — Mate:316, Mate:329
151. COTS_BOSSARD_1400444_M6_Nylon_Nut:22 — Mate:315, Mate:326
152. COTS_BOSSARD_1400444_M6_Nylon_Nut:21 — Mate:314, Mate:327
153. COTS_BOSSARD_1400444_M6_Nylon_Nut:20 — Mate:313, Mate:325
154. COTS_BOSSARD_1400444_M6_Nylon_Nut:19 — Mate:312, Mate:324
155. COTS_BOSSARD_1400444_M6_Nylon_Nut:18 — Mate:308, Mate:321
156. COTS_BOSSARD_1400444_M6_Nylon_Nut:17 — Mate:310, Mate:322
157. COTS_BOSSARD_1400444_M6_Nylon_Nut:16 — Mate:309, Mate:323
158. COTS_BOSSARD_1400444_M6_Nylon_Nut:15 — Mate:311, Mate:320
159. COTS_BOSSARD_1400444_M6_Nylon_Nut:14 — Mate:307, Mate:318
160. COTS_BOSSARD_1400444_M6_Nylon_Nut:13 — Mate:306, Mate:319
161. COTS_DREMEC_8G206M6X50_M6x50_Nylon_Screw:24 — Mate:293, Mate:299, Mate:324
162. COTS_DREMEC_8G206M6X50_M6x50_Nylon_Screw:23 — Mate:292, Mate:297, Mate:327
163. COTS_DREMEC_8G206M6X50_M6x50_Nylon_Screw:22 — Mate:290, Mate:294, Mate:329
164. COTS_DREMEC_8G206M6X50_M6x50_Nylon_Screw:21 — Mate:291, Mate:298, Mate:328
165. COTS_DREMEC_8G206M6X50_M6x50_Nylon_Screw:20 — Mate:289, Mate:295, Mate:326
166. COTS_DREMEC_8G206M6X50_M6x50_Nylon_Screw:19 — Mate:288, Mate:296, Mate:325
167. COTS_DREMEC_8G206M6X50_M6x50_Nylon_Screw:18 — Mate:287, Mate:301, Mate:320
168. COTS_DREMEC_8G206M6X50_M6x50_Nylon_Screw:17 — Mate:286, Mate:300, Mate:318
169. COTS_DREMEC_8G206M6X50_M6x50_Nylon_Screw:16 — Mate:283, Mate:302, Mate:321
170. COTS_DREMEC_8G206M6X50_M6x50_Nylon_Screw:15 — Mate:284, Mate:305, Mate:319
171. COTS_DREMEC_8G206M6X50_M6x50_Nylon_Screw:14 — Mate:285, Mate:303, Mate:322
172. COTS_DREMEC_8G206M6X50_M6x50_Nylon_Screw:13 — Mate:282, Mate:304, Mate:323
173. DIN 934 - replaced by DIN EN 24032/28673/28674 M4:21 — Mate:207, Mate:208, Angle:37
174. DIN 934 - replaced by DIN EN 24032/28673/28674 M4:20 — Mate:205, Mate:206, Angle:38
175. DIN 934 - replaced by DIN EN 24032/28673/28674 M4:19 — Mate:203, Mate:204, Angle:39
176. DIN 934 - replaced by DIN EN 24032/28673/28674 M4:18 — Mate:201, Mate:202, Angle:40
177. DIN 934 - replaced by DIN EN 24032/28673/28674 M4:17 — Mate:199, Mate:200, Angle:33
178. DIN 934 - replaced by DIN EN 24032/28673/28674 M4:16 — Mate:197, Mate:198, Angle:36
179. DIN 934 - replaced by DIN EN 24032/28673/28674 M4:15 — Mate:195, Mate:196, Angle:34
180. DIN 912 - replaced by DIN EN ISO 4762 M4 x 20:8 — Mate:191, Mate:192
181. DIN 912 - replaced by DIN EN ISO 4762 M4 x 20:7 — Mate:189, Mate:190
182. DIN 912 - replaced by DIN EN ISO 4762 M4 x 20:6 — Mate:187, Mate:188
183. DIN 912 - replaced by DIN EN ISO 4762 M4 x 20:5 — Mate:185, Mate:186
184. DIN 912 - replaced by DIN EN ISO 4762 M4 x 20:4 — Mate:183, Mate:184
185. DIN 912 - replaced by DIN EN ISO 4762 M4 x 20:3 — Mate:181, Mate:182
186. DIN 912 - replaced by DIN EN ISO 4762 M4 x 20:2 — Mate:179, Mate:180
187. DIN 934 - replaced by DIN EN 24032/28673/28674 M4:14 — Mate:193, Mate:194, Angle:35
188. DIN 912 - replaced by DIN EN ISO 4762 M4 x 20:1 — Mate:177, Mate:178
189. DIN 934 - replaced by DIN EN 24032/28673/28674 M5:20 — Mate:175, Mate:176, Angle:27
190. DIN 934 - replaced by DIN EN 24032/28673/28674 M5:19 — Mate:173, Mate:174, Angle:28
191. DIN 934 - replaced by DIN EN 24032/28673/28674 M5:18 — Mate:171, Mate:172, Angle:29
192. DIN 934 - replaced by DIN EN 24032/28673/28674 M5:17 — Mate:169, Mate:170, Angle:30
193. DIN 934 - replaced by DIN EN 24032/28673/28674 M5:16 — Mate:167, Mate:168, Angle:31
194. DIN 934 - replaced by DIN EN 24032/28673/28674 M5:15 — Mate:165, Mate:166, Angle:32
195. DIN 934 - replaced by DIN EN 24032/28673/28674 M5:14 — Mate:163, Mate:164, Angle:24
196. DIN 934 - replaced by DIN EN 24032/28673/28674 M5:13 — Mate:161, Mate:162, Angle:23
197. DIN 934 - replaced by DIN EN 24032/28673/28674 M5:12 — Mate:159, Mate:160, Angle:22
198. DIN 934 - replaced by DIN EN 24032/28673/28674 M5:11 — Mate:157, Mate:158, Angle:25
199. DIN 934 - replaced by DIN EN 24032/28673/28674 M5:10 — Mate:155, Mate:156, Angle:26
200. DIN 912 - replaced by DIN EN ISO 4762 M5 x 50:20 — Mate:151, Mate:152
201. DIN 912 - replaced by DIN EN ISO 4762 M5 x 50:19 — Mate:149, Mate:150
202. DIN 912 - replaced by DIN EN ISO 4762 M5 x 50:18 — Mate:147, Mate:148
203. DIN 912 - replaced by DIN EN ISO 4762 M5 x 50:17 — Mate:145, Mate:146
204. DIN 912 - replaced by DIN EN ISO 4762 M5 x 50:16 — Mate:143, Mate:144
205. DIN 912 - replaced by DIN EN ISO 4762 M5 x 50:15 — Mate:141, Mate:142
206. DIN 912 - replaced by DIN EN ISO 4762 M5 x 50:14 — Mate:139, Mate:140
207. DIN 912 - replaced by DIN EN ISO 4762 M5 x 50:13 — Mate:137, Mate:138
208. DIN 912 - replaced by DIN EN ISO 4762 M5 x 50:12 — Mate:135, Mate:136
209. DIN 912 - replaced by DIN EN ISO 4762 M5 x 50:11 — Mate:133, Mate:134
210. DIN 912 - replaced by DIN EN ISO 4762 M5 x 50:10 — Mate:131, Mate:132
211. DIN 934 - replaced by DIN EN 24032/28673/28674 M5:9 — Mate:153, Mate:154, Angle:21
212. DIN 912 - replaced by DIN EN ISO 4762 M5 x 50:9 — Mate:129, Mate:130
213. DIN 934 - replaced by DIN EN 24032/28673/28674 M4:11 — Mate:93, Mate:94, Angle:20
214. DIN 934 - replaced by DIN EN 24032/28673/28674 M4:10 — Mate:91, Mate:92, Angle:19
215. ISO 7380-1 M4 x 40:11 — Mate:87, Mate:88
216. ISO 7380-1 M4 x 40:10 — Mate:85, Mate:86
217. DIN 934 - replaced by DIN EN 24032/28673/28674 M4:9 — Mate:89, Mate:90, Angle:18
218. ISO 7380-1 M4 x 40:9 — Mate:83, Mate:84
219. ISO 7380-1 M3 x 16:4 — Insert:4
220. ISO 7380-1 M3 x 16:3 — Insert:3
221. ISO 7380-1 M3 x 16:2 — Insert:2
222. DIN 125-1 A A 3,2:4 — Mate:116, Mate:117, Insert:4
223. DIN 125-1 A A 3,2:3 — Mate:114, Mate:115, Insert:3
224. DIN 125-1 A A 3,2:2 — Mate:112, Mate:113, Insert:2
225. ISO 7380-1 M3 x 16:1 — Insert:1
226. DIN 125-1 A A 3,2:1 — Mate:110, Mate:111, Insert:1
227. DIN 934 - replaced by DIN EN 24032/28673/28674 M5:8 — Mate:75, Mate:76, Angle:15
228. DIN 934 - replaced by DIN EN 24032/28673/28674 M5:7 — Mate:73, Mate:74, Angle:14
229. DIN 934 - replaced by DIN EN 24032/28673/28674 M5:6 — Mate:71, Mate:72, Angle:13
230. DIN 934 - replaced by DIN EN 24032/28673/28674 M5:5 — Mate:69, Mate:70, Angle:12
231. DIN 934 - replaced by DIN EN 24032/28673/28674 M5:4 — Mate:67, Mate:68, Angle:11
232. DIN 934 - replaced by DIN EN 24032/28673/28674 M5:3 — Mate:65, Mate:66, Angle:10
233. DIN 934 - replaced by DIN EN 24032/28673/28674 M5:2 — Mate:63, Mate:64, Angle:9
234. DIN 912 - replaced by DIN EN ISO 4762 M5 x 50:8 — Mate:59, Mate:60
235. DIN 912 - replaced by DIN EN ISO 4762 M5 x 50:7 — Mate:57, Mate:58
236. DIN 912 - replaced by DIN EN ISO 4762 M5 x 50:6 — Mate:55, Mate:56
237. DIN 912 - replaced by DIN EN ISO 4762 M5 x 50:5 — Mate:53, Mate:54
238. DIN 912 - replaced by DIN EN ISO 4762 M5 x 50:4 — Mate:51, Mate:52
239. DIN 912 - replaced by DIN EN ISO 4762 M5 x 50:3 — Mate:49, Mate:50
240. DIN 912 - replaced by DIN EN ISO 4762 M5 x 50:2 — Mate:47, Mate:48
241. DIN 934 - replaced by DIN EN 24032/28673/28674 M5:1 — Mate:61, Mate:62, Angle:16
242. DIN 912 - replaced by DIN EN ISO 4762 M5 x 50:1 — Mate:45, Mate:46
243. ISO 7380-1 M4 x 40:1 — Mate:8, Mate:9
244. DIN 934 - replaced by DIN EN 24032/28673/28674 M4:1 — Mate:24, Mate:25, Angle:8
245. ISO 7380-1 M4 x 40:2 — Mate:10, Mate:11
246. ISO 7380-1 M4 x 40:3 — Mate:12, Mate:13
247. ISO 7380-1 M4 x 40:4 — Mate:14, Mate:15
248. ISO 7380-1 M4 x 40:5 — Mate:16, Mate:17
249. ISO 7380-1 M4 x 40:6 — Mate:18, Mate:19
250. ISO 7380-1 M4 x 40:7 — Mate:20, Mate:21
251. ISO 7380-1 M4 x 40:8 — Mate:22, Mate:23
252. DIN 934 - replaced by DIN EN 24032/28673/28674 M4:2 — Mate:26, Mate:27, Angle:1
253. DIN 934 - replaced by DIN EN 24032/28673/28674 M4:3 — Mate:28, Mate:29, Angle:2
254. DIN 934 - replaced by DIN EN 24032/28673/28674 M4:4 — Mate:30, Mate:31, Angle:3
255. DIN 934 - replaced by DIN EN 24032/28673/28674 M4:5 — Mate:32, Mate:33, Angle:4
256. DIN 934 - replaced by DIN EN 24032/28673/28674 M4:6 — Mate:34, Mate:35, Angle:5
257. DIN 934 - replaced by DIN EN 24032/28673/28674 M4:7 — Mate:36, Mate:37, Angle:6
258. DIN 934 - replaced by DIN EN 24032/28673/28674 M4:8 — Mate:38, Mate:39, Angle:7
259. COTS_Fleximo_FB12020_20x20_Alu_Profile_575mm:1 — Mate:640, Flush:35, Flush:36, Mate:641, Flush:37, Flush:38, Mate:642, Flush:39, Flush:40, Mate:643, Flush:41, Mate:649, Mate:650, Angle:67, Angle:68, Mate:904, Flush:58
260. 3DP_PLA_Foldable_Leg_Brace_Mount_REVB:1 — Mate:643, Flush:41, Mate:644, Mate:647, Mate:648, Mate:651, Mate:652, Mate:657, Mate:658, Mate:659, Mate:660, Flush:59
261. COTS_GENERIC_5mm_Carbon_Rod:1 — Mate:647, Mate:648
262. COTS_Fleximo_FB12020_20x20_Alu_Profile_600mm:1 — Mate:632, Flush:25, Flush:26, Mate:633, Flush:27, Flush:28, Mate:634, Flush:29, Mate:637, Flush:30, Mate:639, Flush:33, Flush:34, Mate:645, Flush:42, Mate:653, Mate:654, Angle:69, Angle:70, Mate:855, Flush:46, Mate:877, Flush:48, Mate:890, Flush:54, Flush:55, Mate:897, Flush:56, Flush:57
263. COTS_Fleximo_FBP2020_20x20_Hinge:1 — Mate:639, Flush:33, Flush:34, Mate:640, Flush:35, Flush:36
264. COTS_Fleximo_FB1K2020_Angle:1 — Mate:634, Mate:635, Flush:29
265. COTS_Fleximo_FB12020_20x20_Alu_Profile_150mm:2 — Mate:633, Flush:27, Flush:28, Mate:635, Mate:770, Mate:771, Mate:772, Mate:773, Mate:774, Angle:72, Angle:73
266. DIN 125-1 A A 4,3:5 — Mate:777, Mate:778, Insert:28
267. DIN 912 - replaced by DIN EN ISO 4762 M4 x 16:1 — Insert:28
268. DIN 912 - replaced by DIN EN ISO 4762 M4 x 16:2 — Insert:29
269. DIN 125-1 A A 4,3:6 — Mate:779, Mate:780, Insert:29
270. COTS_Fleximo_FB1K2020_Angle:2 — Mate:636, Mate:637, Flush:30
271. 3DP_PLA_Foldable_Leg_Brace_Mount_REVB:2 — Mate:645, Flush:42, Mate:655, Mate:656, Mate:661, Mate:662, Mate:663, Mate:664
272. ISO 7380-1 M3 x 12:4 — Mate:663, Mate:664
273. ISO 7380-1 M3 x 12:3 — Mate:661, Mate:662
274. COTS_Fleximo_FB12020_20x20_Alu_Profile_150mm:1 — Mate:629, Mate:630, Mate:632, Flush:25, Flush:26, Mate:636, Mate:690, Mate:691, Mate:729, Angle:71, Mate:731, Mate:856, Flush:49
275. DIN 912 - replaced by DIN EN ISO 4762 M4 x 10:1 — Insert:27
276. DIN 125-1 A A 4,3:4 — Mate:768, Mate:769, Insert:27
277. ISO 7380-1 M3 x 12:1 — Mate:657, Mate:658
278. ISO 7380-1 M3 x 12:2 — Mate:659, Mate:660
279. COTS_Fleximo_FB1ZP20C_20x20_End_Cap:3 — Mate:642, Flush:39, Flush:40, Mate:644
280. COTS_Fleximo_FB1NM3_M3_Nut_20x20:4 — Mate:650, Angle:67, Mate:651
281. COTS_Fleximo_FB1NM3_M3_Nut_20x20:3 — Mate:653, Angle:70, Mate:656
282. COTS_Fleximo_FB1NM3_M3_Nut_20x20:2 — Mate:654, Angle:69, Mate:655
283. COTS_Fleximo_FB1NM3_M3_Nut_20x20:1 — Mate:649, Angle:68, Mate:652
284. COTS_Fleximo_FB1NM4_M4_Nut_20x20:1 — Mate:729, Angle:71, Mate:730
285. COTS_Fleximo_FB1NM4_M4_Nut_20x20:3 — Mate:774, Angle:73, Mate:776
286. COTS_Fleximo_FB1NM4_M4_Nut_20x20:2 — Mate:773, Angle:72, Mate:775
287. COTS_Fleximo_FB1ZP20C_20x20_End_Cap:2 — Mate:641, Flush:37, Flush:38
288. COTS_Fleximo_FB12020_20x20_Alu_Profile_575mm:2
289. 3DP_PLA_Foldable_Leg_Brace_Mount_REVB:3
290. COTS_GENERIC_5mm_Carbon_Rod:2
291. COTS_Fleximo_FB12020_20x20_Alu_Profile_600mm:2 — Mate:818, Mate:819, Mate:820, Mate:821, Mate:822, Mate:824, Mate:825, Mate:826, Mate:857, Flush:47, Mate:915, Mate:916
292. COTS_Fleximo_FBP2020_20x20_Hinge:2
293. COTS_Fleximo_FB1K2020_Angle:3
294. COTS_Fleximo_FB12020_20x20_Alu_Profile_150mm:3 — Mate:830, Mate:858
295. DIN 125-1 A A 4,3:7
296. DIN 912 - replaced by DIN EN ISO 4762 M4 x 16:3
297. DIN 912 - replaced by DIN EN ISO 4762 M4 x 16:4
298. DIN 125-1 A A 4,3:8
299. COTS_Fleximo_FB1K2020_Angle:4
300. 3DP_PLA_Foldable_Leg_Brace_Mount_REVB:4
301. ISO 7380-1 M3 x 12:5
302. ISO 7380-1 M3 x 12:6
303. COTS_Fleximo_FB12020_20x20_Alu_Profile_150mm:4